# Autodesk Inventor assembly: MA00000176
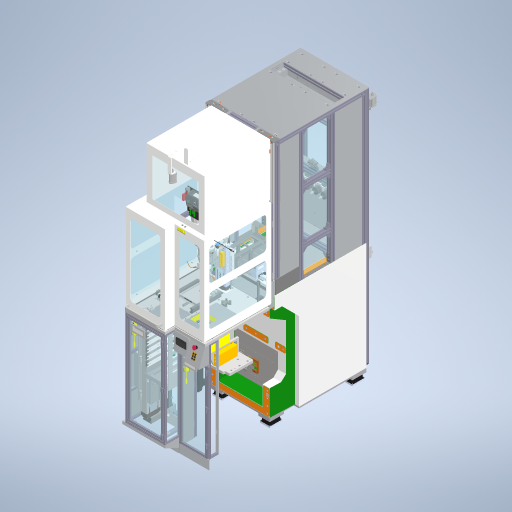
[picture p0: Inventor's stored thumbnail of the model, 512x512]
Saved by Autodesk Inventor 2023.3 (Build 273359000, 359)
## iProperties
RuleStatus: InUse
Created: 2023-01-05
Part Number: MA00000176
Document SubType Name: Assembly
Designer: ric7an
Mass: 1.32085e+06 g
Surface Area: 763155 cm^2
Volume: 412179 cm^3
Density: 3.20455 g/cm^3
Description: Dispensen CIPG L207
AnP_Kategorie: 99
AnP_TemplVers: 20200821
RBDOCUMENTTYPE: DRF
RBDOCUMENTVERSION: 00
RBDRAWINGMAINSCALE: 1:1
RBDRAWINGMISSINGSPEC: --
RBDRAWINGVOLUME: --
RBDSV1: 0850
RBGBEDGESIN1: +0,5
RBGBEDGESIN2: +0,2
RBGBEDGESOUT1: -0,3
RBGBEDGESOUT2: -0,1
RBMATMEETS: --
RBMATNO: =<Part Number>
RBPARTMADEOF: --
RBPARTSAFETYINDICATOR: --
RBSURFACE: --
RBSURFACE2: --
RBZEDGESNORM: ISO13715:2002-06
RBZGENDIMCLASS: m
RBZGENDIMNORM: ISO 2768-1:1989-11
RBZGENGEOCLASS: H
RBZGENGEONORM: ISO 2768-2:1989-11
RBZSURFACENORM: ISO13D2:2002-02
RBZTOLERANCENORM: ISO 14405-1:2010-12
Author: ric7an
Keywords: =<RBPARTMADEOF>
Comments: =<RBSURFACE2>
Revision Number: 01
Title: MM0943AN106_G00_001_SL
## Documents named in this file (31)
- C:\Users\sen8bue\Documents\Inventor\TCAI2412_te1910_EM\MA00000176.iam
- C:\Users\sen8bue\Documents\Inventor\TCAI2412_te1910_EM\AS00000926.iam
- C:\Users\sen8bue\Documents\Inventor\TCAI2412_te1910_EM\AS00000929.iam
- C:\Users\sen8bue\Documents\Inventor\TCAI2412_te1910_EM\AS00000943.iam
- C:\Users\sen8bue\Documents\Inventor\TCAI2412_te1910_EM\AS00000960.iam
- C:\Users\sen8bue\Documents\Inventor\TCAI2412_te1910_EM\PT00004410.ipt
- C:\Users\sen8bue\Documents\Inventor\TCAI2412_te1910_EM\AS00000946.iam
- C:\Users\sen8bue\Documents\Inventor\TCAI2412_te1910_EM\AS00000931.iam
- C:\Users\sen8bue\Documents\Inventor\TCAI2412_te1910_EM\AS00000932.iam
- C:\Users\sen8bue\Documents\Inventor\TCAI2412_te1910_EM\AS00000930.iam
- C:\Users\sen8bue\Documents\Inventor\TCAI2412_te1910_EM\AS00000933.iam
- C:\Users\sen8bue\Documents\Inventor\TCAI2412_te1910_EM\AS00000971.iam
- C:\Users\sen8bue\Documents\Inventor\TCAI2412_te1910_EM\AS00000978.iam
- C:\Users\sen8bue\Documents\Inventor\TCAI2412_te1910_EM\AS00000961.iam
- C:\Users\sen8bue\Documents\Inventor\TCAI2412_te1910_EM\AS00000942.iam
- C:\Users\sen8bue\Documents\Inventor\TCAI2412_te1910_EM\AS00000977.iam
- C:\Users\sen8bue\Documents\Inventor\TCAI2412_te1910_EM\AS00000948.iam
- C:\Users\sen8bue\Documents\Inventor\TCAI2412_te1910_EM\AS00000970.iam
- C:\Users\sen8bue\Documents\Inventor\TCAI2412_te1910_EM\AS00000959.iam
- C:\Users\sen8bue\Documents\Inventor\TCAI2412_te1910_EM\AS00000958.iam
- C:\Users\sen8bue\Documents\Inventor\TCAI2412_te1910_EM\AS00000969.iam
- C:\Users\sen8bue\Documents\Inventor\TCAI2412_te1910_EM\AS00000973.iam
- C:\Users\sen8bue\Documents\Inventor\TCAI2412_te1910_EM\AS00000913.iam
- C:\Users\sen8bue\Documents\Inventor\TCAI2412_te1910_EM\AS00000908.iam
- C:\Users\sen8bue\Documents\Inventor\TCAI2412_te1910_EM\AS00000894.iam
- C:\Users\sen8bue\Documents\Inventor\TCAI2412_te1910_EM\AS00000897.iam
- C:\Users\sen8bue\Documents\Inventor\TCAI2412_te1910_EM\AS00000944.iam
- C:\Users\sen8bue\Documents\Inventor\TCAI2412_te1910_EM\AS00000949.iam
- C:\Users\sen8bue\Documents\Inventor\TCAI2412_te1910_EM\AS00000924.iam
- C:\Users\sen8bue\Documents\Inventor\TCAI2412_te1910_EM\AS00000925.iam
- C:\_AnPCAD\_AnP_CAD\MM\MM0943AN_L207_LT5\MM0943AN105_CIPG\G00\MM0943AN105_G00_001.iam
## Components (29 placed, 29 different names)
1. AS00000977:1 [sub-assembly] — Fluchtend:159
2. AS00000925:1 [sub-assembly]
3. PT00004410:1
4. AS00000978:1 [sub-assembly] — Passend:96
5. AS00000973:1 [sub-assembly] — Passend:103, Einfügen:48, Passend:104, Einfügen:49, Einfügen:50, Passend:109
6. AS00000913:1 [sub-assembly] — Passend:105, Fluchtend:162
7. AS00000894:1 [sub-assembly] — Fluchtend:163, Fluchtend:164, Fluchtend:165
8. AS00000897:1 [sub-assembly] — Fluchtend:166, Fluchtend:167, Fluchtend:168
9. AS00000944:1 [sub-assembly] — Einfügen:50, Passend:109
10. AS00000949:1 [sub-assembly] — Einfügen:51, Passend:114
11. AS00000924:1 [sub-assembly] — Passend:115
12. AS00000908:1 [sub-assembly]
13. AS00000926:1 [sub-assembly]
14. AS00000929:1 [sub-assembly] — Einfügen:48, Passend:104
15. AS00000930:1 [sub-assembly] — Passend:90, Passend:91, Passend:92
16. AS00000931:1 [sub-assembly]
17. AS00000932:1 [sub-assembly] — Fluchtend:155, Fluchtend:156, Fluchtend:157
18. AS00000933:1 [sub-assembly] — Fluchtend:137, Fluchtend:138, Fluchtend:139, Passend:115
19. AS00000942:1 [sub-assembly] — Passend:100, Passend:101, Passend:102
20. AS00000943:1 [sub-assembly] — Fluchtend:120, Fluchtend:121, Fluchtend:122, Passend:103, Einfügen:49
21. AS00000946:1 [sub-assembly] — Fluchtend:126, Fluchtend:127, Fluchtend:128
22. AS00000948:1 [sub-assembly] — Fluchtend:159
23. AS00000958:1 [sub-assembly] — Fluchtend:129, Fluchtend:130, Fluchtend:131
24. AS00000959:1 [sub-assembly] — Fluchtend:152, Fluchtend:153, Fluchtend:154
25. AS00000960:1 [sub-assembly] — Fluchtend:124, Fluchtend:123, Fluchtend:125
26. AS00000961:1 [sub-assembly] — Einfügen:51, Passend:114
27. AS00000969:1 [sub-assembly] — Passend:105, Fluchtend:162
28. AS00000970:1 [sub-assembly] — Passend:76, Passend:77, Fluchtend:119
29. AS00000971:1 [sub-assembly] — Fluchtend:142, Fluchtend:143, Fluchtend:144, Passend:100, Passend:101, Passend:102
## Relationships (83: Flush 51, Mate 26, Insert 6)
- [Insert]: AS00000926:1 ↔ AS00000929:1
- [Mate]: AS00000926:1 ↔ AS00000929:1
- [Insert]: AS00000929:1 ↔ AS00000931:1
- [Mate]: AS00000929:1 ↔ AS00000931:1
- [Mate]: AS00000948:1 ↔ AS00000970:1
- [Flush]: AS00000948:1 ↔ AS00000970:1
- [Flush]: PT00004410:1
- [Flush]: PT00004410:1
- [Flush]: PT00004410:1
- [Flush]: AS00000969:1
- [Flush]: AS00000969:1
- [Flush]: AS00000969:1
- [Flush]: AS00000961:1
- [Flush]: AS00000961:1
- [Flush]: AS00000961:1
- Passend:76 [Mate]: AS00000970:1
- Passend:77 [Mate]: AS00000970:1
- Fluchtend:119 [Flush]: AS00000970:1
- [Mate]: AS00000977:1 ↔ AS00000961:1
- Fluchtend:120 [Flush]: AS00000943:1
- Fluchtend:121 [Flush]: AS00000943:1
- Fluchtend:122 [Flush]: AS00000943:1
- Fluchtend:124 [Flush]: AS00000960:1
- Fluchtend:123 [Flush]: AS00000960:1
- Fluchtend:125 [Flush]: AS00000960:1
- Fluchtend:126 [Flush]: AS00000946:1
- Fluchtend:127 [Flush]: AS00000946:1
- Fluchtend:128 [Flush]: AS00000946:1
- [Mate]: AS00000977:1 ↔ AS00000946:1
- Fluchtend:129 [Flush]: AS00000958:1
- Fluchtend:130 [Flush]: AS00000958:1
- Fluchtend:131 [Flush]: AS00000958:1
- [Mate] (-105 mm): AS00000977:1
- [Flush] (105 mm): AS00000948:1
- Fluchtend:137 [Flush]: AS00000933:1
- Fluchtend:138 [Flush]: AS00000933:1
- Fluchtend:139 [Flush]: AS00000933:1
- Fluchtend:142 [Flush]: AS00000971:1
- Fluchtend:143 [Flush]: AS00000971:1
- Fluchtend:144 [Flush]: AS00000971:1
- [Flush] (105 mm): AS00000908:1
- [Flush]: AS00000908:1
- [Flush]: AS00000908:1
- [Flush]: AS00000942:1
- [Flush] (13 mm): AS00000942:1
- [Flush]: AS00000942:1
- Fluchtend:152 [Flush]: AS00000959:1
- Fluchtend:153 [Flush]: AS00000959:1
- Fluchtend:154 [Flush]: AS00000959:1
- Fluchtend:155 [Flush]: AS00000932:1
- Fluchtend:156 [Flush]: AS00000932:1
- Fluchtend:157 [Flush]: AS00000932:1
- Passend:90 [Mate]: AS00000930:1
- Passend:91 [Mate]: AS00000930:1
- Passend:92 [Mate]: AS00000930:1
- [Flush] (-50 mm): AS00000978:1 ↔ AS00000961:1
- Passend:96 [Mate] (350 mm): AS00000978:1
- [Mate] (-15 mm): AS00000978:1 ↔ AS00000961:1
- Fluchtend:159 [Flush] (-325 mm): AS00000977:1 ↔ AS00000948:1
- Passend:100 [Mate]: AS00000942:1 ↔ AS00000971:1
- Passend:101 [Mate]: AS00000942:1 ↔ AS00000971:1
- Passend:102 [Mate]: AS00000942:1 ↔ AS00000971:1
- Passend:103 [Mate]: AS00000973:1 ↔ AS00000943:1
- Einfügen:48 [Insert]: AS00000973:1 ↔ AS00000929:1
- Passend:104 [Mate]: AS00000973:1 ↔ AS00000929:1
- Passend:105 [Mate]: AS00000913:1 ↔ AS00000969:1
- Fluchtend:162 [Flush]: AS00000913:1 ↔ AS00000969:1
- Einfügen:49 [Insert]: AS00000973:1 ↔ AS00000943:1
- Fluchtend:163 [Flush]: AS00000894:1
- Fluchtend:164 [Flush]: AS00000894:1
- Fluchtend:165 [Flush]: AS00000894:1
- Fluchtend:166 [Flush]: AS00000897:1
- Fluchtend:167 [Flush]: AS00000897:1
- Fluchtend:168 [Flush]: AS00000897:1
- Einfügen:50 [Insert]: AS00000973:1 ↔ AS00000944:1
- Passend:109 [Mate]: AS00000973:1 ↔ AS00000944:1
- Einfügen:51 [Insert]: AS00000949:1 ↔ AS00000961:1
- [Mate]: AS00000949:1 ↔ AS00000961:1
- Passend:114 [Mate]: AS00000949:1 ↔ AS00000961:1
- Passend:115 [Mate]: AS00000924:1 ↔ AS00000933:1
- [Mate]: AS00000925:1 ↔ AS00000933:1
- [Mate] (5 mm): AS00000925:1 ↔ AS00000933:1
- [Mate] (-30 mm): AS00000925:1 ↔ AS00000933:1
## Named parameters: d80_d270 = 0 mm, d81_d205 = 0 mm, AbstandModulmitte = 105 mm, d477_d442 = 0 mm, d479_d444 = -30 mm
